# Autodesk Inventor assembly: iterasi3
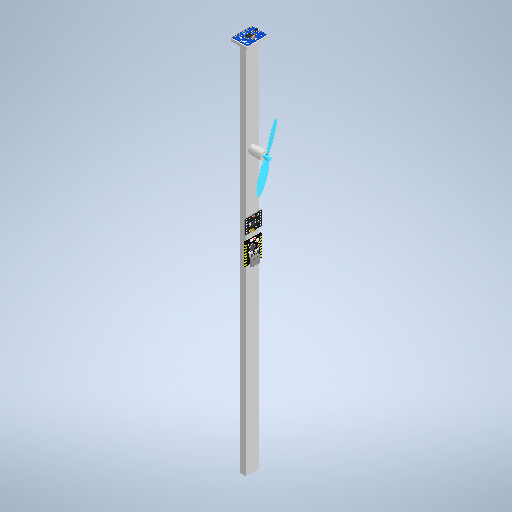
[picture p0: Inventor's stored thumbnail of the model, 512x512]
Saved by Autodesk Inventor 2026.2 (Build 302298010, 298A)
## iProperties
Created: 2026-11-17
Part Number: iterasi3
Document SubType Name: Assembly
Designer: Acer
Author: Acer
## Documents named in this file (7)
- D:\Cool Yeah\Semester 3\Praktikum SKD\Projek-Akhir\3Dmodel\iterasi3.iam
- D:\Cool Yeah\Semester 3\Praktikum SKD\Projek-Akhir\3Dmodel\iterasi3-cetak.ipt
- D:\Cool Yeah\Semester 3\Praktikum SKD\Projek-Akhir\3Dmodel\MPU6050\MPU6050 Accelerometer\MPU6050 Accelerometer\MPU6050 Accelerometer.ipt
- D:\Cool Yeah\Semester 3\Praktikum SKD\Projek-Akhir\3Dmodel\drv8833-motor-driver-1.snapshot.2\DRV8833\DRV8833\DRV8833.ipt
- D:\Cool Yeah\Semester 3\Praktikum SKD\Projek-Akhir\3Dmodel\8520-coreless-brushed-motor-1.snapshot.2\8520 Coreless Brshed motor\8520 Coreless Brshed motor\8520 Coreless Brshed motor.ipt
- D:\Cool Yeah\Semester 3\Praktikum SKD\Projek-Akhir\3Dmodel\propeller-65-mm-helice-65mm-1.snapshot.5\helice-ccw-65mm\helice-ccw-65mm\helice-ccw-65mm.ipt
- D:\Cool Yeah\Semester 3\Praktikum SKD\Projek-Akhir\3Dmodel\mc-esp32-c3-super-mini-black-pink-red-1.snapshot.21\ESP32 C3 Super mini\ESP32 C3 Super mini\ESP32 C3 Super mini.ipt
## Components (6 placed, 6 different names)
1. iterasi3-cetak:1 — Mate:1, Mate:2, Mate:3, Insert:1, Mate:4, Mate:5, Mate:6
2. MPU6050 Accelerometer:2 — Mate:1, Mate:2, Mate:3
3. 8520 Coreless Brshed motor:2 — Insert:1, Insert:2
4. helice-ccw-65mm:2 — Insert:2
5. ESP32 C3 Super mini:2 — Mate:4
6. DRV8833:1 — Mate:5, Mate:6
## Relationships (8: Mate 6, Insert 2)
- Mate:1: iterasi3-cetak:1 ↔ MPU6050 Accelerometer:2
- Mate:2: iterasi3-cetak:1 ↔ MPU6050 Accelerometer:2
- Mate:3: iterasi3-cetak:1 ↔ MPU6050 Accelerometer:2
- Insert:1: iterasi3-cetak:1 ↔ 8520 Coreless Brshed motor:2
- Insert:2: 8520 Coreless Brshed motor:2 ↔ helice-ccw-65mm:2
- Mate:4: iterasi3-cetak:1 ↔ ESP32 C3 Super mini:2
- Mate:5: iterasi3-cetak:1 ↔ DRV8833:1
- Mate:6 (160 mm): iterasi3-cetak:1 ↔ DRV8833:1
